# Autodesk Inventor assembly: PCleanerV3
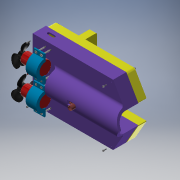
[picture p0: Inventor's stored thumbnail of the model, 180x180]
Saved by Autodesk Inventor 2019 (Build 230136000, 136)
## iProperties
Created: 2019-03-21
Part Number: PCleanerV3
Document SubType Name: Assembly
Designer: Dell
Author: Dell
## Documents named in this file (23)
- D:\(C)\Engineering\6.Senior 1\Semester 8\Design of MCT (2)\PCleanerV3\PCleanerV3.iam
- D:\(C)\Engineering\6.Senior 1\Semester 8\Design of MCT (2)\PCleanerV3\new base.ipt
- D:\(C)\Engineering\6.Senior 1\Semester 8\Design of MCT (2)\PCleanerV3\aquarium pump head.ipt
- D:\(C)\Engineering\6.Senior 1\Semester 8\Design of MCT (2)\PCleanerV3\pump filter.ipt
- D:\(C)\Engineering\6.Senior 1\Semester 8\Design of MCT (2)\PCleanerV3\Pump Holder.ipt
- D:\(C)\Engineering\6.Senior 1\Semester 8\Design of MCT (2)\PCleanerV3\Bilge-pump.ipt
- D:\(C)\Engineering\6.Senior 1\Semester 8\Design of MCT (2)\PCleanerV3\prop.ipt
- D:\(C)\Engineering\6.Senior 1\Semester 8\Design of MCT (2)\PCleanerV3\floating bed.ipt
- D:\(C)\Engineering\6.Senior 1\Semester 8\Design of MCT (2)\PCleanerV3\Bilge Pump Holder.ipt
- D:\(C)\Engineering\6.Senior 1\Semester 8\Design of MCT (2)\PCleanerV3\air pump tube.ipt
- D:\(C)\Engineering\6.Senior 1\Semester 8\Design of MCT (2)\PCleanerV3\Chassis.ipt
- C:\Users\Dell\Documents\Inventor\Content Center Files\R2019\en-US\CSN 02 1174  B\CSN 02 1174 - B M5 x 45.ipt
- C:\Users\Dell\Documents\Inventor\Content Center Files\R2019\en-US\CSN EN 24035\ISO 4035 - M5CSN EN.ipt
- C:\Users\Dell\Documents\Inventor\Content Center Files\R2019\en-US\CSN EN 24035\ISO 4035 - M2.5CSN EN.ipt
- D:\(C)\Engineering\6.Senior 1\Semester 8\Design of MCT (2)\PCleanerV3\Capteur Pluie2 v3.ipt
- D:\(C)\Engineering\6.Senior 1\Semester 8\Design of MCT (2)\PCleanerV3\5mm LED.ipt
- C:\Users\Dell\Documents\Inventor\Content Center Files\R2019\en-US\CSN 02 1174  B\CSN 02 1174 - B M3 x 12.ipt
- C:\Users\Dell\Documents\Inventor\Content Center Files\R2019\en-US\CNS 3128\CNS 3128 - M 3 x 0.5.ipt
- C:\Users\Dell\Documents\Inventor\Content Center Files\R2019\en-US\BS 4183(1)\BS 4183 - M2.5(1).ipt
- C:\Users\Dell\Documents\Inventor\Content Center Files\R2019\en-US\AS 1110\AS 1110 - M2.5 x 10.ipt
- C:\Users\Dell\Documents\Inventor\Content Center Files\R2019\en-US\BS EN 24035\ISO 4035 - M5BS EN.ipt
- C:\Users\Dell\Documents\Inventor\Content Center Files\R2019\en-US\BS EN 24035\ISO 4035 - M4BS EN.ipt
- D:\(C)\Engineering\6.Senior 1\Semester 8\Design of MCT (2)\PCleanerV3\Button.ipt
## Components (65 placed, 22 different names)
1. new base:1 — Mate:2, Angle:1, Mate:4, Mate:5, Flush:2, Mate:14, Flush:4, Flush:5, Angle:2, Angle:3, Flush:6, Mate:28, Mate:29, Insert:5, Insert:6, Insert:9, Insert:10, Insert:11, Insert:12, Insert:13, Insert:14, Insert:15, Insert:16, Insert:17, Insert:18, Flush:7, Flush:8, Mate:47, Mate:48, Mate:49, Mate:65, Mate:66, Insert:26, Insert:27, Insert:28, Insert:29, Insert:30, Insert:31, Insert:32, Insert:33
2. aquarium pump head:1 — Mate:3, Mate:4, Mate:5, Mate:8, Mate:9, Flush:3, Mate:26, Mate:27
3. pump filter:1 — Mate:8, Mate:9
4. Pump Holder:1 — Mate:2, Angle:1, Mate:3, Flush:2, Flush:3
5. prop:1 — Mate:10, Mate:11
6. Bilge-pump:2 — Mate:10, Mate:11, Mate:16, Mate:19, Mate:23
7. prop:2
8. Bilge-pump:3 — Mate:17, Mate:18, Mate:22
9. floating bed:1 — Mate:14, Flush:4, Flush:5, Mate:20, Mate:22, Mate:23, Insert:19, Insert:20, Insert:21, Insert:22, Mate:55, Mate:56, Mate:57, Mate:58
10. Bilge Pump Holder:1 — Mate:16, Mate:19
11. Bilge Pump Holder:2 — Mate:17, Mate:18, Mate:20, Mate:74
12. air pump tube:1 — Mate:26, Mate:27, Angle:2, Angle:3
13. Chassis:1 — Flush:6, Mate:28, Mate:29, Mate:31, Mate:33, Mate:37, Mate:38, Mate:39, Mate:41, Mate:42, Mate:45, Mate:46, Mate:75, Mate:76
14. CSN 02 1174 B B M5 x 45:1 — Insert:5, Mate:40
15. CSN 02 1174 B B M5 x 45:2 — Insert:6, Mate:34
16. CSN 02 1174 B B M5 x 45:3 — Insert:12, Mate:32
17. CSN 02 1174 B B M5 x 45:4 — Insert:11, Mate:36
18. CSN 02 1174 B B M5 x 45:5 — Insert:9, Mate:35
19. CSN 02 1174 B B M5 x 45:6 — Insert:10, Mate:30
20. CSN EN 24035 M5:1 — Mate:30, Mate:31
21. CSN EN 24035 M5:2 — Mate:32, Mate:33
22. CSN EN 24035 M5:3 — Mate:34, Mate:38
23. CSN EN 24035 M5:4 — Mate:35, Mate:37
24. CSN EN 24035 M5:5 — Mate:36, Mate:39
25. CSN EN 24035 M2.5:1 — Insert:13
26. CSN EN 24035 M2.5:2 — Insert:14
27. CSN EN 24035 M2.5:3 — Insert:15
28. CSN EN 24035 M2.5:4 — Insert:16
29. CSN EN 24035 M2.5:5 — Insert:17
30. CSN EN 24035 M2.5:6 — Insert:18
31. CSN EN 24035 M5:6 — Mate:40, Mate:41
32. Capteur Pluie2 v3:1 — Mate:42, Flush:7, Flush:8, Mate:59, Mate:60, Mate:61, Mate:62
33. 5mm LED:1 — Mate:45
34. 5mm LED:2 — Mate:46
35. Capteur Pluie2 v3:2 — Mate:47, Mate:48, Mate:49
36. CSN 02 1174 B B M3 x 12:1 — Insert:19, Mate:54
37. CSN 02 1174 B B M3 x 12:2 — Insert:20, Mate:51
38. CSN 02 1174 B B M3 x 12:3 — Insert:21, Mate:52
39. CSN 02 1174 B B M3 x 12:4 — Insert:22, Mate:53
40. CNS 3128 M 3:1 — Mate:51, Mate:57
41. CNS 3128 M 3:2 — Mate:52, Mate:58
42. CNS 3128 M 3:3 — Mate:53, Mate:56
43. CNS 3128 M 3:4 — Mate:54, Mate:55
44. AS 1110 - Metric M2.5 x 10:2 — Mate:59, Mate:61, Mate:64
45. AS 1110 - Metric M2.5 x 10:1 — Mate:60, Mate:62, Mate:63
46. BS 4183 - Metric M2.5:1 — Mate:63, Mate:66
47. BS 4183 - Metric M2.5:2 — Mate:64, Mate:65
48. CSN 02 1174 B B M5 x 45:7 — Insert:26, Mate:73, Flush:9
49. CSN 02 1174 B B M5 x 45:8 — Insert:27, Mate:72
50. CSN 02 1174 B B M5 x 45:9 — Insert:28, Flush:11
51. CSN 02 1174 B B M5 x 45:10 — Insert:29, Mate:67, Flush:10
52. CSN 02 1174 B B M5 x 45:11 — Insert:30, Flush:13
53. CSN 02 1174 B B M5 x 45:12 — Insert:31, Mate:68, Flush:12
54. CSN 02 1174 B B M5 x 45:13
55. CSN 02 1174 B B M5 x 45:15 — Insert:32, Mate:70, Flush:14
56. CSN 02 1174 B B M5 x 45:16 — Insert:33, Mate:69, Flush:15
57. BS EN 24035 - Metric M5:1 — Mate:67, Flush:10
58. BS EN 24035 - Metric M5:2 — Mate:68, Flush:12
59. BS EN 24035 - Metric M5:3 — Mate:69, Flush:15
60. BS EN 24035 - Metric M5:4 — Mate:70, Flush:14
61. BS EN 24035 - Metric M5:5 — Flush:13
62. BS EN 24035 - Metric M4:1 — Flush:11
63. BS EN 24035 - Metric M5:6 — Mate:72, Mate:74
64. BS EN 24035 - Metric M5:7 — Mate:73, Flush:9
65. Button:1 — Mate:75, Mate:76
## Relationships (106: Mate 65, Insert 24, Flush 14, Angle 3)
- Mate:2: new base:1 ↔ Pump Holder:1
- Angle:1 (180 deg): new base:1 ↔ Pump Holder:1
- Mate:3: aquarium pump head:1 ↔ Pump Holder:1
- Mate:4: new base:1 ↔ aquarium pump head:1
- Mate:5: new base:1 ↔ aquarium pump head:1
- Mate:8: aquarium pump head:1 ↔ pump filter:1
- Mate:9: aquarium pump head:1 ↔ pump filter:1
- Mate:10: prop:1 ↔ Bilge-pump:2
- Mate:11: prop:1 ↔ Bilge-pump:2
- [Mate]: prop:2 ↔ Bilge-pump:3
- [Mate]: prop:2 ↔ Bilge-pump:3
- Flush:2: new base:1 ↔ Pump Holder:1
- Flush:3: aquarium pump head:1 ↔ Pump Holder:1
- Mate:14: new base:1 ↔ floating bed:1
- Flush:4 (2 mm): new base:1 ↔ floating bed:1
- Flush:5: new base:1 ↔ floating bed:1
- Mate:16: Bilge-pump:2 ↔ Bilge Pump Holder:1
- Mate:17: Bilge-pump:3 ↔ Bilge Pump Holder:2
- Mate:18: Bilge-pump:3 ↔ Bilge Pump Holder:2
- Mate:19: Bilge-pump:2 ↔ Bilge Pump Holder:1
- Mate:20: floating bed:1 ↔ Bilge Pump Holder:2
- Mate:22: Bilge-pump:3 ↔ floating bed:1
- Mate:23: Bilge-pump:2 ↔ floating bed:1
- Mate:26: aquarium pump head:1 ↔ air pump tube:1
- Mate:27 (-8 mm): aquarium pump head:1 ↔ air pump tube:1
- Angle:2 (0 deg): new base:1 ↔ air pump tube:1
- Angle:3 (90 deg): new base:1 ↔ air pump tube:1
- Flush:6: new base:1 ↔ Chassis:1
- Mate:28: new base:1 ↔ Chassis:1
- Mate:29: new base:1 ↔ Chassis:1
- Insert:5: new base:1 ↔ CSN 02 1174 B B M5 x 45:1
- Insert:6: new base:1 ↔ CSN 02 1174 B B M5 x 45:2
- Insert:9: new base:1 ↔ CSN 02 1174 B B M5 x 45:5
- Insert:10: new base:1 ↔ CSN 02 1174 B B M5 x 45:6
- Insert:11: new base:1 ↔ CSN 02 1174 B B M5 x 45:4
- Insert:12: new base:1 ↔ CSN 02 1174 B B M5 x 45:3
- Mate:30: CSN 02 1174 B B M5 x 45:6 ↔ CSN EN 24035 M5:1
- Mate:31: Chassis:1 ↔ CSN EN 24035 M5:1
- Mate:32: CSN 02 1174 B B M5 x 45:3 ↔ CSN EN 24035 M5:2
- Mate:33: Chassis:1 ↔ CSN EN 24035 M5:2
- Mate:34: CSN 02 1174 B B M5 x 45:2 ↔ CSN EN 24035 M5:3
- Mate:35: CSN 02 1174 B B M5 x 45:5 ↔ CSN EN 24035 M5:4
- Mate:36: CSN 02 1174 B B M5 x 45:4 ↔ CSN EN 24035 M5:5
- Insert:13: new base:1 ↔ CSN EN 24035 M2.5:1
- Insert:14: new base:1 ↔ CSN EN 24035 M2.5:2
- Insert:15: new base:1 ↔ CSN EN 24035 M2.5:3
- Insert:16: new base:1 ↔ CSN EN 24035 M2.5:4
- Insert:17: new base:1 ↔ CSN EN 24035 M2.5:5
- Insert:18: new base:1 ↔ CSN EN 24035 M2.5:6
- Mate:37: Chassis:1 ↔ CSN EN 24035 M5:4
- Mate:38: Chassis:1 ↔ CSN EN 24035 M5:3
- Mate:39: Chassis:1 ↔ CSN EN 24035 M5:5
- Mate:40: CSN 02 1174 B B M5 x 45:1 ↔ CSN EN 24035 M5:6
- Mate:41: Chassis:1 ↔ CSN EN 24035 M5:6
- Mate:42: Chassis:1 ↔ Capteur Pluie2 v3:1
- Flush:7 (-20 mm): new base:1 ↔ Capteur Pluie2 v3:1
- Flush:8 (-106 mm): new base:1 ↔ Capteur Pluie2 v3:1
- Mate:45: Chassis:1 ↔ 5mm LED:1
- Mate:46: Chassis:1 ↔ 5mm LED:2
- Mate:47: new base:1 ↔ Capteur Pluie2 v3:2
- Mate:48: new base:1 ↔ Capteur Pluie2 v3:2
- Mate:49 (15 mm): new base:1 ↔ Capteur Pluie2 v3:2
- Insert:19 (-10.3067 mm): floating bed:1 ↔ CSN 02 1174 B B M3 x 12:1
- Insert:20 (-10.3067 mm): floating bed:1 ↔ CSN 02 1174 B B M3 x 12:2
- Insert:21 (-10.3067 mm): floating bed:1 ↔ CSN 02 1174 B B M3 x 12:3
- Insert:22 (-10.3067 mm): floating bed:1 ↔ CSN 02 1174 B B M3 x 12:4
- Mate:51: CSN 02 1174 B B M3 x 12:2 ↔ CNS 3128 M 3:1
- Mate:52: CSN 02 1174 B B M3 x 12:3 ↔ CNS 3128 M 3:2
- Mate:53: CSN 02 1174 B B M3 x 12:4 ↔ CNS 3128 M 3:3
- Mate:54: CSN 02 1174 B B M3 x 12:1 ↔ CNS 3128 M 3:4
- Mate:55: floating bed:1 ↔ CNS 3128 M 3:4
- Mate:56: floating bed:1 ↔ CNS 3128 M 3:3
- Mate:57: floating bed:1 ↔ CNS 3128 M 3:1
- Mate:58: floating bed:1 ↔ CNS 3128 M 3:2
- Mate:59: Capteur Pluie2 v3:1 ↔ AS 1110 - Metric M2.5 x 10:2
- Mate:60: Capteur Pluie2 v3:1 ↔ AS 1110 - Metric M2.5 x 10:1
- Mate:61: Capteur Pluie2 v3:1 ↔ AS 1110 - Metric M2.5 x 10:2
- Mate:62: Capteur Pluie2 v3:1 ↔ AS 1110 - Metric M2.5 x 10:1
- Mate:63: AS 1110 - Metric M2.5 x 10:1 ↔ BS 4183 - Metric M2.5:1
- Mate:64: AS 1110 - Metric M2.5 x 10:2 ↔ BS 4183 - Metric M2.5:2
- Mate:65: new base:1 ↔ BS 4183 - Metric M2.5:2
- Mate:66: new base:1 ↔ BS 4183 - Metric M2.5:1
- Insert:26: new base:1 ↔ CSN 02 1174 B B M5 x 45:7
- Insert:27: new base:1 ↔ CSN 02 1174 B B M5 x 45:8
- Insert:28: new base:1 ↔ CSN 02 1174 B B M5 x 45:9
- Insert:29: new base:1 ↔ CSN 02 1174 B B M5 x 45:10
- Insert:30: new base:1 ↔ CSN 02 1174 B B M5 x 45:11
- Insert:31: new base:1 ↔ CSN 02 1174 B B M5 x 45:12
- Insert:32: new base:1 ↔ CSN 02 1174 B B M5 x 45:15
- Insert:33: new base:1 ↔ CSN 02 1174 B B M5 x 45:16
- Mate:67: CSN 02 1174 B B M5 x 45:10 ↔ BS EN 24035 - Metric M5:1
- Mate:68: CSN 02 1174 B B M5 x 45:12 ↔ BS EN 24035 - Metric M5:2
- Mate:69: CSN 02 1174 B B M5 x 45:16 ↔ BS EN 24035 - Metric M5:3
- Mate:70: CSN 02 1174 B B M5 x 45:15 ↔ BS EN 24035 - Metric M5:4
- Mate:72: CSN 02 1174 B B M5 x 45:8 ↔ BS EN 24035 - Metric M5:6
- Mate:73: CSN 02 1174 B B M5 x 45:7 ↔ BS EN 24035 - Metric M5:7
- Mate:74: Bilge Pump Holder:2 ↔ BS EN 24035 - Metric M5:6
- Flush:9 (1.96 mm): CSN 02 1174 B B M5 x 45:7 ↔ BS EN 24035 - Metric M5:7
- Flush:10 (1.96 mm): CSN 02 1174 B B M5 x 45:10 ↔ BS EN 24035 - Metric M5:1
- Flush:11 (-1.96 mm): CSN 02 1174 B B M5 x 45:9 ↔ BS EN 24035 - Metric M4:1
- Flush:12 (-1.96 mm): CSN 02 1174 B B M5 x 45:12 ↔ BS EN 24035 - Metric M5:2
- Flush:13 (-1.96 mm): CSN 02 1174 B B M5 x 45:11 ↔ BS EN 24035 - Metric M5:5
- Flush:14 (1.96 mm): CSN 02 1174 B B M5 x 45:15 ↔ BS EN 24035 - Metric M5:4
- Flush:15 (-1.96 mm): CSN 02 1174 B B M5 x 45:16 ↔ BS EN 24035 - Metric M5:3
- Mate:75: Chassis:1 ↔ Button:1
- Mate:76: Chassis:1 ↔ Button:1
## Named parameters: d18_d16 = 0 mm, d19_d17 = 0 mm
